# Autodesk Inventor assembly: MM0948AN140_G00_803
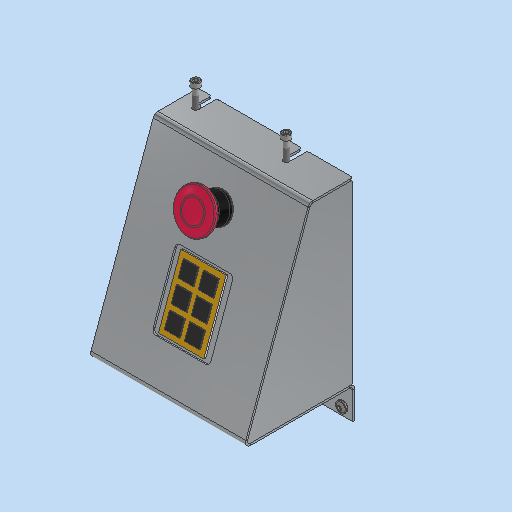
[picture p0: Inventor's stored thumbnail of the model, 512x512]
Saved by Autodesk Inventor 2023.3 (Build 273359000, 359)
## iProperties
Created: 2023-03-23
Part Number: MM0948AN140_G00_803
Description: =<RBPARTNOTITLE2>
Document SubType Name: Assembly
Designer: FH/Wi
Mass: 505.709 g
Surface Area: 1886.61 cm^2
Volume: 181.901 cm^3
Density: 2.78013 g/cm^3
AnP_Kategorie: 98
AnP_Material: =<Material>
AnP_TemplVers: 20200821
RBDOCUMENTTYPE: DRF
RBDOCUMENTVERSION: 00
RBDRAWINGMAINSCALE: 1:1
RBDRAWINGMISSINGSPEC: --
RBDRAWINGVOLUME: --
RBDSV1: 0850
RBGBEDGESIN1: +0,5
RBGBEDGESIN2: +0,2
RBGBEDGESOUT1: -0,3
RBGBEDGESOUT2: -0,1
RBMATERIAL: =<Material>
RBMATMEETS: --
RBMATNO: =<Part Number>
RBPARTMADEOF: --
RBPARTNO: SIEHE MNR
RBPARTNOTITLE1: enter description here
RBPARTNOTITLE2: hier Bezeichnung eintragen
RBPARTSAFETYINDICATOR: --
RBSURFACE: --
RBSURFACE2: --
RBZEDGESNORM: ISO13715:2002-06
RBZGENDIMCLASS: m
RBZGENDIMNORM: ISO 2768-1:1989-11
RBZGENGEOCLASS: H
RBZGENGEONORM: ISO 2768-2:1989-11
RBZSURFACENORM: ISO13D2:2002-02
RBZTOLERANCENORM: ISO 14405-1:2010-12
Author: FH/Wi
Keywords: =<RBPARTMADEOF>
Comments: =<RBSURFACE2>
Revision Number: 01
## Documents named in this file (9)
- C:\Users\rea9an\Documents\Inventor\TCAI2412_te1910_EM\AS00000953.iam
- C:\Users\rea9an\Documents\Inventor\TCAI2412_te1910_EM\AS00000957.iam
- C:\Users\rea9an\Documents\Inventor\TCAI2412_te1910_EM\AS00000900.iam
- C:\Users\rea9an\Documents\Inventor\TCAI2412_te1910_EM\PT00004355.ipt
- C:\Users\rea9an\Documents\Inventor\TCAI2412_te1910_EM\PT00004819.ipt
- C:\Users\rea9an\Documents\Inventor\TCAI2412_te1910_EM\PT00004883.ipt
- C:\Users\rea9an\Documents\Inventor\TCAI2412_te1910_EM\PT00004389.ipt
- C:\Users\rea9an\Documents\Inventor\TCAI2412_te1910_EM\PT00004779.ipt
- C:\_AnPCAD\_AnP_CAD\MM\MM0948AN_DispensenStandardbaugruppen\MM0948AN140_Schutz\G00\MM0948AN140_G00_803.iam
## Components (11 placed, 7 different names)
1. AS00000957:1 [sub-assembly] — Passend:3, Passend:15, Passend:17, Einfügen:1, Einfügen:2
2. AS00000900:1 [sub-assembly] — Passend:3
3. PT00004355:1
4. PT00004819:1
5. PT00004883:1 — Passend:15
6. PT00004389:1 — Einfügen:4
7. PT00004389:2 — Einfügen:3
8. PT00004883:2 — Passend:17
9. PT00004819:3
10. PT00004779:1 — Einfügen:1, Einfügen:3
11. PT00004779:2 — Einfügen:2, Einfügen:4
## Relationships (18: Mate 11, Insert 4, Flush 2, Angle 1)
- [Mate]: AS00000957:1 ↔ AS00000900:1
- [Mate] (2.75 mm): AS00000957:1 ↔ AS00000900:1
- Passend:3 [Mate] (5.8 mm): AS00000957:1 ↔ AS00000900:1
- [Mate]: AS00000957:1 ↔ PT00004355:1
- [Mate]: AS00000957:1 ↔ PT00004355:1
- [Angle] (0 deg): AS00000957:1 ↔ PT00004355:1
- [Mate]: AS00000957:1 ↔ PT00004819:1
- [Mate]: PT00004819:1 ↔ PT00004883:1
- [Mate] (2.75 mm): AS00000957:1 ↔ PT00004883:1
- [Flush]: PT00004883:1 ↔ PT00004883:2
- [Mate]: PT00004883:2 ↔ PT00004819:3
- [Flush]: PT00004883:1 ↔ PT00004883:2
- Passend:15 [Mate] (19.3 mm): AS00000957:1 ↔ PT00004883:1
- Passend:17 [Mate]: AS00000957:1 ↔ PT00004883:2
- Einfügen:1 [Insert]: AS00000957:1 ↔ PT00004779:1
- Einfügen:2 [Insert]: AS00000957:1 ↔ PT00004779:2
- Einfügen:3 [Insert]: PT00004389:2 ↔ PT00004779:1
- Einfügen:4 [Insert]: PT00004389:1 ↔ PT00004779:2
